# Autodesk Inventor assembly: 部件1
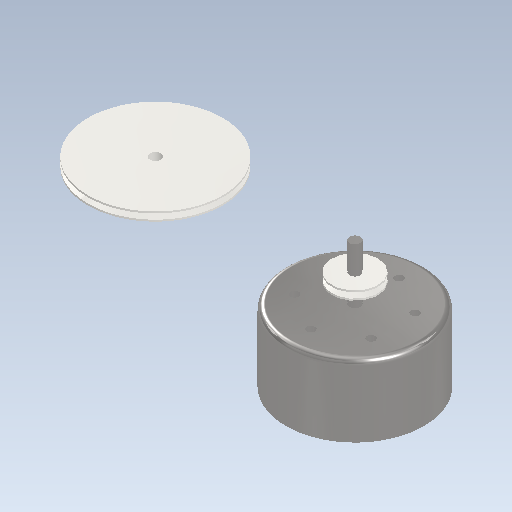
[picture p0: Inventor's stored thumbnail of the model, 512x512]
Saved by Autodesk Inventor 2021 (Build 250183000, 183)
## iProperties
Created: 2024-05-08
Part Number: 部件1
Document SubType Name: Assembly
Designer: admin
Author: admin
## Documents named in this file (4)
- E:\月球车模型-许诺\部件1.iam
- E:\月球车模型-许诺\300电机.ipt
- E:\月球车模型-许诺\月球车模型-姓名\皮带轮.ipt
- E:\月球车模型-许诺\月球车模型-姓名\皮带轮2.ipt
## Components (3 placed, 3 different names)
1. 300电机:1 — 刚性:1
2. 皮带轮2:1 — 刚性:1, 表面齐平:1, 表面齐平:2
3. 皮带轮1:1 — 表面齐平:1, 表面齐平:2
## Relationships (3: Flush 2, WeldJoint 1)
- 刚性:1 [WeldJoint]: 300电机:1 ↔ 皮带轮2:1
- 表面齐平:1 [Flush]: 皮带轮2:1 ↔ 皮带轮1:1
- 表面齐平:2 [Flush]: 皮带轮2:1 ↔ 皮带轮1:1
